# Autodesk Inventor assembly: pattern-two
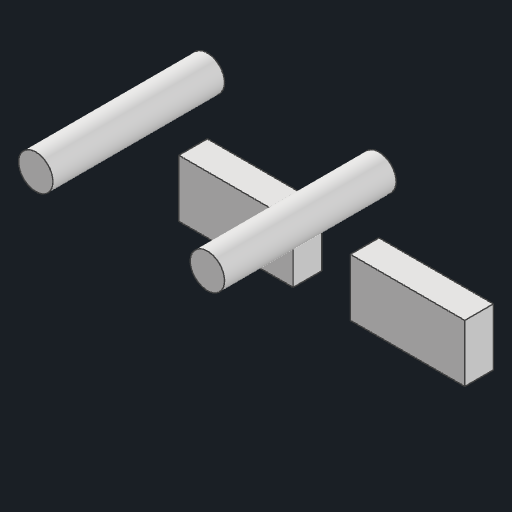
[picture p0: Inventor's stored thumbnail of the model, 512x512]
Saved by Autodesk Inventor 2026.1 (Build 301233000, 233)
## iProperties
Created: 2026-10-30
Part Number: pattern-two
Document SubType Name: Assembly
Designer: david
Author: anony
## Documents named in this file (3)
- C:\Users\anony\OneDrive\Desktop\AI Projects\CAD Convert\corpus\generated\asm\pattern-two.iam
- C:\Users\anony\OneDrive\Desktop\AI Projects\CAD Convert\corpus\generated\asmparts\box.ipt
- C:\Users\anony\OneDrive\Desktop\AI Projects\CAD Convert\corpus\generated\asmparts\pin.ipt
## Components (4 placed, 2 different names)
1. box:1
2. pin:1
3. box:2
4. pin:2
## Component patterns: (2 elements, first: box:1 + pin:1)
